# Autodesk Inventor assembly: PororoHumanoid
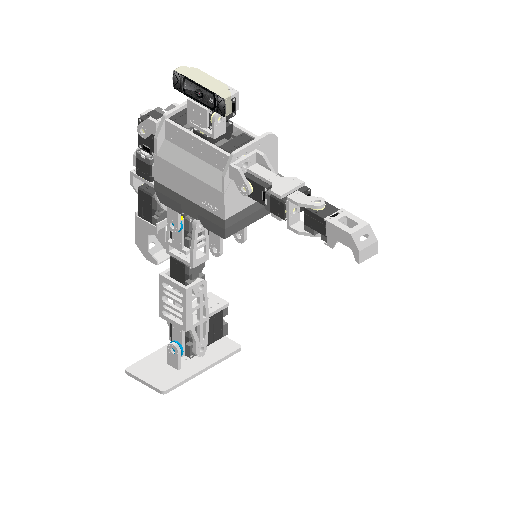
[picture p0: Inventor's stored thumbnail of the model, 512x512]
Saved by Autodesk Inventor 2025.2 (Build 292293000, 293)
## iProperties
Created: 2025-06-20
Part Number: PororoHumanoid
Document SubType Name: Assembly
Designer: ricoa
Author: ricoa
## Documents named in this file (12)
- C:\Users\ricoa\Desktop\PROYEK AKHIR\project_pororo\PororoHumanoid.iam
- C:\Users\ricoa\Desktop\PROYEK AKHIR\project_pororo\XM430-W350-R\XM430-W350-R\XM430-W350-R.iam
- C:\Users\ricoa\Desktop\PROYEK AKHIR\project_pororo\Body\BodyBackLock.ipt
- C:\Users\ricoa\Desktop\PROYEK AKHIR\project_pororo\Body\MainBottom.ipt
- C:\Users\ricoa\Desktop\PROYEK AKHIR\project_pororo\Leg\LegL.iam
- C:\Users\ricoa\Desktop\PROYEK AKHIR\project_pororo\Body\BodyFront.ipt
- C:\Users\ricoa\Desktop\PROYEK AKHIR\project_pororo\Body\BodySide.ipt
- C:\Users\ricoa\Desktop\PROYEK AKHIR\project_pororo\Arm\ArmAssemblyL.iam
- C:\Users\ricoa\Desktop\PROYEK AKHIR\project_pororo\Body\BodyBottom.ipt
- C:\Users\ricoa\Desktop\PROYEK AKHIR\project_pororo\Head\HeadAssembly.iam
- C:\Users\ricoa\Desktop\PROYEK AKHIR\project_pororo\Arm\ArmAssemblyR.iam
- C:\Users\ricoa\Desktop\PROYEK AKHIR\project_pororo\Leg\LegR.iam
## Components (15 placed, 11 different names)
1. XM430-W350-R:1 [sub-assembly] — Mate:8, Mate:9, Flush:9, Mate:49, Mate:50, Mate:51, Mate:56, Mate:57
2. XM430-W350-R:2 [sub-assembly] — Mate:5, Mate:6, Flush:2, Flush:8, Mate:46, Mate:47, Mate:48, Mate:55
3. BodyBackLock:1 — Mate:5, Mate:6, Mate:8, Mate:9, Mate:32, Mate:58, Mate:61, Mate:62
4. XM430-W350-R:3 [sub-assembly] — Flush:8, Flush:9, Mate:32, Mate:41, Mate:42, Mate:45, Mate:58
5. MainBottom:1 — Flush:1, Mate:28, Mate:29, Flush:2, Flush:7, Mate:52, Mate:53, Mate:54, Mate:63, Mate:64, Mate:65, Mate:66, Mate:67, Mate:68, Mate:69
6. LegL:1 [sub-assembly] — Mate:67, Mate:68, Mate:69
7. BodyFront:1 — Flush:1, Mate:28, Mate:29
8. BodySide:1 — Flush:7, Mate:61, Mate:62
9. BodySide:2 — Mate:59, Mate:60, Mate:63
10. ArmAssemblyL:1 [sub-assembly] — Mate:46, Mate:47, Mate:48
11. BodyBottom:1 — Mate:64, Mate:65, Mate:66
12. HeadAssembly:1 [sub-assembly] — Mate:41, Mate:42, Mate:45
13. ArmAssemblyR:1 [sub-assembly] — Mate:49, Mate:50, Mate:51
14. LegR:1 [sub-assembly] — Mate:52, Mate:53, Mate:54
15. BodyBackLock:2 — Mate:55, Mate:56, Mate:57, Mate:59, Mate:60
## Relationships (39: Mate 34, Flush 5)
- Mate:5: XM430-W350-R:2 ↔ BodyBackLock:1
- Mate:6: XM430-W350-R:2 ↔ BodyBackLock:1
- Mate:8: XM430-W350-R:1 ↔ BodyBackLock:1
- Mate:9: XM430-W350-R:1 ↔ BodyBackLock:1
- Flush:1: MainBottom:1 ↔ BodyFront:1
- Mate:28: MainBottom:1 ↔ BodyFront:1
- Mate:29: MainBottom:1 ↔ BodyFront:1
- Flush:2: XM430-W350-R:2 ↔ MainBottom:1
- Flush:7: MainBottom:1 ↔ BodySide:1
- Flush:8: XM430-W350-R:2 ↔ XM430-W350-R:3
- Flush:9: XM430-W350-R:1 ↔ XM430-W350-R:3
- Mate:32: BodyBackLock:1 ↔ XM430-W350-R:3
- Mate:41: XM430-W350-R:3 ↔ HeadAssembly:1
- Mate:42: XM430-W350-R:3 ↔ HeadAssembly:1
- Mate:45: XM430-W350-R:3 ↔ HeadAssembly:1
- Mate:46: XM430-W350-R:2 ↔ ArmAssemblyL:1
- Mate:47: XM430-W350-R:2 ↔ ArmAssemblyL:1
- Mate:48: XM430-W350-R:2 ↔ ArmAssemblyL:1
- Mate:49: XM430-W350-R:1 ↔ ArmAssemblyR:1
- Mate:50: XM430-W350-R:1 ↔ ArmAssemblyR:1
- Mate:51: XM430-W350-R:1 ↔ ArmAssemblyR:1
- Mate:52: MainBottom:1 ↔ LegR:1
- Mate:53: MainBottom:1 ↔ LegR:1
- Mate:54: MainBottom:1 ↔ LegR:1
- Mate:55: XM430-W350-R:2 ↔ BodyBackLock:2
- Mate:56: XM430-W350-R:1 ↔ BodyBackLock:2
- Mate:57: XM430-W350-R:1 ↔ BodyBackLock:2
- Mate:58: BodyBackLock:1 ↔ XM430-W350-R:3
- Mate:59: BodySide:2 ↔ BodyBackLock:2
- Mate:60: BodySide:2 ↔ BodyBackLock:2
- Mate:61: BodyBackLock:1 ↔ BodySide:1
- Mate:62: BodyBackLock:1 ↔ BodySide:1
- Mate:63: MainBottom:1 ↔ BodySide:2
- Mate:64: MainBottom:1 ↔ BodyBottom:1
- Mate:65: MainBottom:1 ↔ BodyBottom:1
- Mate:66: MainBottom:1 ↔ BodyBottom:1
- Mate:67: MainBottom:1 ↔ LegL:1
- Mate:68: MainBottom:1 ↔ LegL:1
- Mate:69: MainBottom:1 ↔ LegL:1
